# Autodesk Inventor assembly: Redutor_Aberto
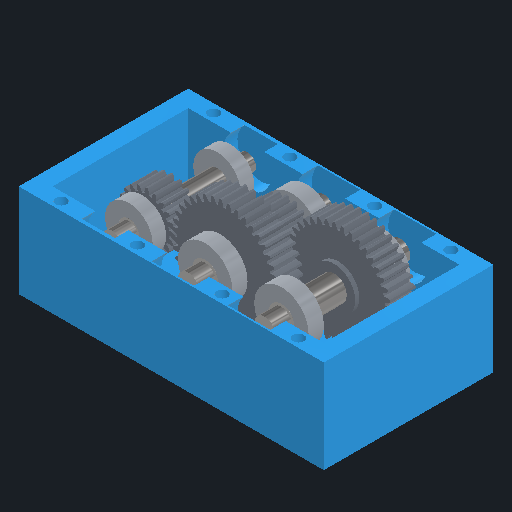
[picture p0: Inventor's stored thumbnail of the model, 512x512]
Saved by Autodesk Inventor 2027 (Build 310192000, 192)
## iProperties
Created: 2026-11-10
Part Number: Redutor_Aberto
Description: Redutor de velocidade - tampa superior oculta
Document SubType Name: Assembly
Designer: Bruno Madela
Author: Bruno Madela
## Documents named in this file (11)
- C:\Users\Bruno Madela.DESKTOP-3A0VRE3\Documents\A3\Inventor_v3\Montagem_Redutor_Aberto.iam
- C:\Users\Bruno Madela.DESKTOP-3A0VRE3\Documents\A3\Inventor_v3\Carcaca_inferior.ipt
- C:\Users\Bruno Madela.DESKTOP-3A0VRE3\Documents\A3\Inventor_v3\E1.ipt
- C:\Users\Bruno Madela.DESKTOP-3A0VRE3\Documents\A3\Inventor_v3\E2.ipt
- C:\Users\Bruno Madela.DESKTOP-3A0VRE3\Documents\A3\Inventor_v3\E3.ipt
- C:\Users\Bruno Madela.DESKTOP-3A0VRE3\Documents\A3\Inventor_v3\G1.ipt
- C:\Users\Bruno Madela.DESKTOP-3A0VRE3\Documents\A3\Inventor_v3\G2.ipt
- C:\Users\Bruno Madela.DESKTOP-3A0VRE3\Documents\A3\Inventor_v3\G3.ipt
- C:\Users\Bruno Madela.DESKTOP-3A0VRE3\Documents\A3\Inventor_v3\G4.ipt
- C:\Users\Bruno Madela.DESKTOP-3A0VRE3\Documents\A3\Inventor_v3\Rolamento_6001.ipt
- C:\Users\Bruno Madela.DESKTOP-3A0VRE3\Documents\A3\Inventor_v3\Rolamento_6002.ipt
## Components (14 placed, 10 different names)
1. Carcaca_inferior:1 — Coincidente:1, Coincidente:2, Coincidente:3, Coincidente:4, Coincidente:5, Alinhado:4, Coincidente:6, Alinhado:5, Coincidente:7, Alinhado:6, Coincidente:8, Alinhado:7, Coincidente:9, Alinhado:8, Coincidente:10, Alinhado:9, Coincidente:11, Alinhado:10, Coincidente:12, Alinhado:11, Coincidente:13, Alinhado:12, Coincidente:14, Alinhado:13, Coincidente:15, Alinhado:14
2. E1:1 — Coincidente:1, Coincidente:2
3. E2:1 — Coincidente:3, Coincidente:4
4. E3:1 — Coincidente:5, Alinhado:4
5. G1:1 — Coincidente:6, Alinhado:5
6. G2:1 — Coincidente:7, Alinhado:6
7. G3:1 — Coincidente:8, Alinhado:7
8. G4:1 — Coincidente:9, Alinhado:8
9. Rolamento_6001:1 — Coincidente:10, Alinhado:9
10. Rolamento_6001:2 — Coincidente:11, Alinhado:10
11. Rolamento_6002:1 — Coincidente:12, Alinhado:11
12. Rolamento_6002:2 — Coincidente:13, Alinhado:12
13. Rolamento_6002:3 — Coincidente:14, Alinhado:13
14. Rolamento_6002:4 — Coincidente:15, Alinhado:14
## Relationships (26: Mate 15, Flush 11)
- Coincidente:1 [Mate]: Carcaca_inferior:1 ↔ E1:1
- Coincidente:2 [Mate] (90 mm): Carcaca_inferior:1 ↔ E1:1
- Coincidente:3 [Mate]: Carcaca_inferior:1 ↔ E2:1
- Coincidente:4 [Mate] (90 mm): Carcaca_inferior:1 ↔ E2:1
- Coincidente:5 [Mate]: Carcaca_inferior:1 ↔ E3:1
- Alinhado:4 [Flush] (-10 mm): Carcaca_inferior:1 ↔ E3:1
- Coincidente:6 [Mate]: Carcaca_inferior:1 ↔ G1:1
- Alinhado:5 [Flush] (-52 mm): Carcaca_inferior:1 ↔ G1:1
- Coincidente:7 [Mate]: Carcaca_inferior:1 ↔ G2:1
- Alinhado:6 [Flush] (-51 mm): Carcaca_inferior:1 ↔ G2:1
- Coincidente:8 [Mate]: Carcaca_inferior:1 ↔ G3:1
- Alinhado:7 [Flush] (-29 mm): Carcaca_inferior:1 ↔ G3:1
- Coincidente:9 [Mate]: Carcaca_inferior:1 ↔ G4:1
- Alinhado:8 [Flush] (-29 mm): Carcaca_inferior:1 ↔ G4:1
- Coincidente:10 [Mate]: Carcaca_inferior:1 ↔ Rolamento_6001:1
- Alinhado:9 [Flush] (-72 mm): Carcaca_inferior:1 ↔ Rolamento_6001:1
- Coincidente:11 [Mate]: Carcaca_inferior:1 ↔ Rolamento_6001:2
- Alinhado:10 [Flush] (-20 mm): Carcaca_inferior:1 ↔ Rolamento_6001:2
- Coincidente:12 [Mate]: Carcaca_inferior:1 ↔ Rolamento_6002:1
- Alinhado:11 [Flush] (-71 mm): Carcaca_inferior:1 ↔ Rolamento_6002:1
- Coincidente:13 [Mate]: Carcaca_inferior:1 ↔ Rolamento_6002:2
- Alinhado:12 [Flush] (-20 mm): Carcaca_inferior:1 ↔ Rolamento_6002:2
- Coincidente:14 [Mate]: Carcaca_inferior:1 ↔ Rolamento_6002:3
- Alinhado:13 [Flush] (-71 mm): Carcaca_inferior:1 ↔ Rolamento_6002:3
- Coincidente:15 [Mate]: Carcaca_inferior:1 ↔ Rolamento_6002:4
- Alinhado:14 [Flush] (-20 mm): Carcaca_inferior:1 ↔ Rolamento_6002:4
